# Autodesk Inventor assembly: 2026-03-04-22-40-07-637
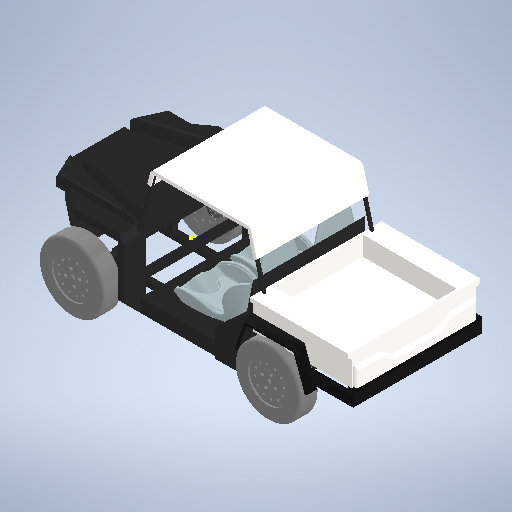
[picture p0: Inventor's stored thumbnail of the model, 512x512]
Saved by Autodesk Inventor 2025 (Build 290162000, 162)
## iProperties
Created: 2026-03-05
Part Number: 2026-03-04-22-40-07-637
Document SubType Name: Assembly
Designer: novsa
Mass: 2.55441e+06 g
Surface Area: 298501 cm^2
Volume: 686606 cm^3
Density: 3.72034 g/cm^3
Title: AssemblyA.step
Sending System: Autodesk Translation Framework v14.24.0.0
Preprocessor: ST-DEVELOPER v20.1
## Documents named in this file (19)
- C:\Users\novsa.4SUS\Downloads\Assembly EV\Assembly EV.iam
- C:\Users\novsa.4SUS\Downloads\Assembly EV\Sasis Mobil.ipt
- C:\Users\novsa.4SUS\Downloads\Assembly EV\Gerobakyaitulah.ipt
- C:\Users\novsa.4SUS\Downloads\Assembly EV\body bawwah.ipt
- C:\Users\novsa.4SUS\Downloads\Assembly EV\Roof Angelus.ipt
- C:\Users\novsa.4SUS\Downloads\Assembly EV\tiang belakang 60.5.ipt
- C:\Users\novsa.4SUS\Downloads\Assembly EV\tiang depan 80cm.ipt
- C:\Users\novsa.4SUS\Downloads\Assembly EV\depan roof.ipt
- C:\Users\novsa.4SUS\Downloads\Assembly EV\roof back.ipt
- C:\Users\novsa.4SUS\Downloads\Assembly EV\Tire.ipt
- C:\Users\novsa.4SUS\Downloads\Assembly EV\Racing Car Chair.ipt
- C:\Users\novsa.4SUS\Downloads\Assembly EV\Steering Wheel.iam
- C:\Users\novsa.4SUS\Downloads\Assembly EV\skirt T-Guard.ipt
- C:\Users\novsa.4SUS\Downloads\Assembly EV\Assembly EV\AIP\FEA\fd05s9lnk.fins
- C:\Users\novsa.4SUS\Downloads\Assembly EV\Assembly EV\AIP\FEA\fd05s9lnk.fsat
- C:\Users\novsa.4SUS\Downloads\Assembly EV\Assembly EV\AIP\FEA\fd05s9lnk.ftes
- C:\Users\novsa.4SUS\Downloads\Assembly EV\Assembly EV\AIP\FEA\fd05s9log.fwiz
- C:\Users\novsa.4SUS\Downloads\Assembly EV\Assembly EV\AIP\FEA\fd05s9me8.fmsh
- C:\Users\novsa.4SUS\Downloads\Assembly EV\Assembly EV\AIP\FEA\fd05s9me9.fres
## Components (18 placed, 12 different names)
1. Sasis Mobil:1 — Insert:1, Insert:2, Insert:5
2. Gerobakyaitulah:1 — Mate:1, Mate:2
3. body bawwah:1 — Insert:3, Insert:4, Mate:1, Insert:6, Insert:7
4. Roof Angelus:1
5. tiang belakang 60.5:1
6. tiang belakang 60.5:2
7. tiang depan 80cm:1
8. tiang depan 80cm:2
9. depan roof:1
10. roof back:1
11. Tire:1 — Insert:1
12. Tire:2 — Insert:2
13. Racing Car Chair:2
14. Racing Car Chair:3
15. Steering Wheel:1 [sub-assembly] — Insert:5
16. skirt T-Guard:1 — Mate:2
17. Tire:3 — Insert:3, Insert:6
18. Tire:4 — Insert:4, Insert:7
## Relationships (9: Insert 7, Mate 2)
- Insert:1: Sasis Mobil:1 ↔ Tire:1
- Insert:2: Sasis Mobil:1 ↔ Tire:2
- Insert:3: body bawwah:1 ↔ Tire:3
- Insert:4: body bawwah:1 ↔ Tire:4
- Insert:5: Sasis Mobil:1 ↔ Steering Wheel:1
- Mate:1: Gerobakyaitulah:1 ↔ body bawwah:1
- Insert:6: body bawwah:1 ↔ Tire:3
- Insert:7: body bawwah:1 ↔ Tire:4
- Mate:2: Gerobakyaitulah:1 ↔ skirt T-Guard:1
## Named parameters: sa_0 = 16667.5, sa_1 = 68645
note: some values were not read from the file. Shown as the stored number, unit unknown: "sa_0", "sa_1".
